# Autodesk Inventor assembly: 传动2
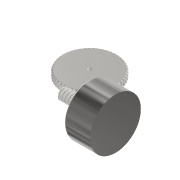
[picture p0: Inventor's stored thumbnail of the model, 180x180]
Saved by Autodesk Inventor 2021 (Build 250183000, 183)
## iProperties
Created: 2024-05-13
Part Number: 传动2
Document SubType Name: Assembly
Designer: teacher
Author: teacher
## Documents named in this file (4)
- C:\Users\teacher\Desktop\月球车模型-姓名\传动2.iam
- C:\Users\teacher\Desktop\月球车模型-姓名\300电机.ipt
- C:\Users\teacher\Desktop\月球车模型-姓名\蜗杆.ipt
- C:\Users\teacher\Desktop\月球车模型-姓名\蜗轮.ipt
## Components (3 placed, 3 different names)
1. 300电机:1 — 圆柱:1
2. 蜗杆:1 — 圆柱:1
3. 蜗轮:1
## Relationships (1: CylindricalJoint 1)
- 圆柱:1 [CylindricalJoint]: 300电机:1 ↔ 蜗杆:1
